# Autodesk Inventor assembly: Assembly1
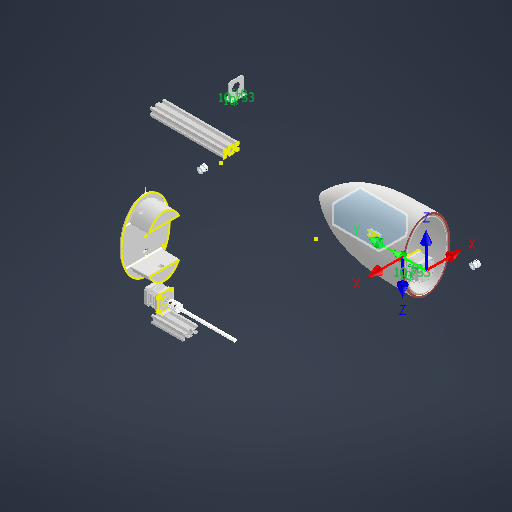
[picture p0: Inventor's stored thumbnail of the model, 512x512]
Saved by Autodesk Inventor 2027 (Build 310192060, 192F)
## iProperties
Created: 2026-06-12
Part Number: Assembly1
Document SubType Name: Assembly
Designer: thita
Author: thita
## Documents named in this file (26)
- D:\Year2\đồ án tốt nghịp\new fish\DESIGN_VIT_ME\Workgroups\new\Assembly1.iam
- D:\Year2\đồ án tốt nghịp\new fish\DESIGN_VIT_ME\Workgroups\new\DESIGN\Workgroups\NotInProject\NotInProject\DAU.ipt
- D:\Year2\đồ án tốt nghịp\new fish\DESIGN_VIT_ME\Workgroups\new\GP2Y0A02YK0F SHARP.ipt
- D:\Year2\đồ án tốt nghịp\new fish\DESIGN_VIT_ME\Workgroups\new\Khối pin sạc Li-ion 12V 21Ah 30A 3S MTM.ipt
- D:\Year2\đồ án tốt nghịp\new fish\DESIGN_VIT_ME\Workgroups\new\DESIGN\Workgroups\NotInProject\NotInProject\NAP.ipt
- D:\Year2\đồ án tốt nghịp\new fish\DESIGN_VIT_ME\Workgroups\new\2040ALUMINIUM PROFIL 35CM.ipt
- D:\Year2\đồ án tốt nghịp\new fish\DESIGN_VIT_ME\Workgroups\new\Step - Nema 17 - 17HS4401S - Usongshine.ipt
- D:\Year2\đồ án tốt nghịp\new fish\DESIGN_VIT_ME\Workgroups\new\GT2_20T.ipt
- D:\Year2\đồ án tốt nghịp\new fish\DESIGN_VIT_ME\Workgroups\new\gia_gan_stepper_va_2040.ipt
- D:\Year2\đồ án tốt nghịp\new fish\DESIGN_VIT_ME\Workgroups\new\2040ALUMINIUM PROFIL 35CM_MIR.ipt
- D:\Year2\đồ án tốt nghịp\new fish\DESIGN_VIT_ME\Workgroups\new\Step - Nema 17 - 17HS4401S - Usongshine_MIR.ipt
- D:\Year2\đồ án tốt nghịp\new fish\DESIGN_VIT_ME\Workgroups\new\gia_gan_stepper_va_2040_MIR.ipt
- D:\Year2\đồ án tốt nghịp\new fish\DESIGN_VIT_ME\Workgroups\new\GT2_20T_MIR2.ipt
- D:\Year2\đồ án tốt nghịp\new fish\DESIGN_VIT_ME\Workgroups\new\Step - Nema 17 - 17HS4401S - Usongshine_MIR_MIR.ipt
- D:\Year2\đồ án tốt nghịp\new fish\DESIGN_VIT_ME\Workgroups\new\GT2_20T_MIR2_MIR.ipt
- D:\Year2\đồ án tốt nghịp\new fish\DESIGN_VIT_ME\Workgroups\new\Gia_truc_z.ipt
- D:\Year2\đồ án tốt nghịp\new fish\DESIGN_VIT_ME\Workgroups\new\5mm to 8mm rigid shaft coupler v2.ipt
- D:\Year2\đồ án tốt nghịp\new fish\DESIGN_VIT_ME\Workgroups\new\vitme-t8-buoc2.ipt
- D:\Year2\đồ án tốt nghịp\new fish\DESIGN_VIT_ME\Workgroups\new\2040ALUMINIUM PROFIL 35CM_MIR_MIR.ipt
- D:\Year2\đồ án tốt nghịp\new fish\DESIGN_VIT_ME\Workgroups\new\gia_gan_stepper_va_2040_MIR_MIR_MIR.ipt
- D:\Year2\đồ án tốt nghịp\new fish\DESIGN_VIT_ME\Workgroups\new\GT2_20T_MIR2_MIR_MIR.ipt
- D:\Year2\đồ án tốt nghịp\new fish\DESIGN_VIT_ME\Workgroups\new\Step - Nema 17 - 17HS4401S - Usongshine_MIR1.ipt
- D:\Year2\đồ án tốt nghịp\new fish\DESIGN_VIT_ME\Workgroups\new\Gia_truc_z_MIR.ipt
- D:\Year2\đồ án tốt nghịp\new fish\DESIGN_VIT_ME\Workgroups\new\5mm to 8mm rigid shaft coupler v2_MIR.ipt
- D:\Year2\đồ án tốt nghịp\new fish\DESIGN_VIT_ME\Workgroups\new\vitme-t8-buoc2_MIR.ipt
- D:\Year2\đồ án tốt nghịp\new fish\DESIGN_VIT_ME\Workgroups\new\Goi Do Dai Oc.ipt
## Components (28 placed, 25 different names)
1. DAU:1 — Mate:4, Mate:5, Mate:6, Mate:7
2. GP2Y0A02YK0F SHARP:1 — Mate:6, Mate:7
3. GP2Y0A02YK0F SHARP:2 — Mate:4, Mate:5
4. Khối pin sạc Li-ion 12V 21Ah 30A 3S MTM:1 — Mate:22
5. NAP:1
6. 2040ALUMINIUM PROFIL 35CM:1 — Mate:1, Mate:2, Mate:3
7. Step - Nema 17 - 17HS4401S - Usongshine:1 — Rigid:1, Rigid:2
8. GT2_20T:1 — Rigid:2
9. gia_gan_stepper_va_2040:1 — Rigid:1, Mate:1, Mate:2, Mate:3
10. 2040ALUMINIUM PROFIL 35CM_MIR:1 — Mate:8, Mate:10, Mate:15, Mate:21, Mate:23
11. Step - Nema 17 - 17HS4401S - Usongshine_MIR:1 — Rigid:4
12. gia_gan_stepper_va_2040_MIR:1 — Mate:8, Mate:10, Rigid:4
13. GT2_20T_MIR2:1
14. Step - Nema 17 - 17HS4401S - Usongshine_MIR_MIR:1 — Rotational:1
15. GT2_20T_MIR2_MIR:1 — Rotational:1
16. Step - Nema 17 - 17HS4401S - Usongshine:2 — Rigid:6, Rotational:2
17. Goi Do Dai Oc:1 — Mate:21, Mate:22
18. Gia_truc_z:1 — Rigid:6, Mate:15, Mate:23
19. 5mm to 8mm rigid shaft coupler v2:1 — Rotational:2, Rigid:7
20. vitme-t8-buoc2:1 — Rigid:7
21. Gia_truc_z:2
22. 2040ALUMINIUM PROFIL 35CM_MIR_MIR:1 — Mate:16, Mate:17, Mate:18, Mate:19, Mate:20
23. gia_gan_stepper_va_2040_MIR_MIR_MIR:1 — Mate:16, Mate:17, Mate:18
24. GT2_20T_MIR2_MIR_MIR:1
25. Step - Nema 17 - 17HS4401S - Usongshine_MIR1:1 — Rigid:8, Rotational:3
26. Gia_truc_z_MIR:1 — Mate:19, Mate:20, Rigid:8
27. 5mm to 8mm rigid shaft coupler v2_MIR:1 — Rotational:3, Rigid:9
28. vitme-t8-buoc2_MIR:1 — Rigid:9
## Relationships (28: Mate 18, WeldJoint 7, RevoluteJoint 3)
- Rigid:1 [WeldJoint]: Step - Nema 17 - 17HS4401S - Usongshine:1 ↔ gia_gan_stepper_va_2040:1
- Mate:1: 2040ALUMINIUM PROFIL 35CM:1 ↔ gia_gan_stepper_va_2040:1
- Mate:2: 2040ALUMINIUM PROFIL 35CM:1 ↔ gia_gan_stepper_va_2040:1
- Mate:3 (20 mm): 2040ALUMINIUM PROFIL 35CM:1 ↔ gia_gan_stepper_va_2040:1
- Rigid:2 [WeldJoint] (-13 mm): Step - Nema 17 - 17HS4401S - Usongshine:1 ↔ GT2_20T:1
- Mate:4: DAU:1 ↔ GP2Y0A02YK0F SHARP:2
- Mate:5: DAU:1 ↔ GP2Y0A02YK0F SHARP:2
- Mate:6: DAU:1 ↔ GP2Y0A02YK0F SHARP:1
- Mate:7: DAU:1 ↔ GP2Y0A02YK0F SHARP:1
- Mate:8 (20 mm): 2040ALUMINIUM PROFIL 35CM_MIR:1 ↔ gia_gan_stepper_va_2040_MIR:1
- Mate:10: 2040ALUMINIUM PROFIL 35CM_MIR:1 ↔ gia_gan_stepper_va_2040_MIR:1
- Rigid:4 [WeldJoint]: Step - Nema 17 - 17HS4401S - Usongshine_MIR:1 ↔ gia_gan_stepper_va_2040_MIR:1
- Rotational:1 [RevoluteJoint] (3 mm): Step - Nema 17 - 17HS4401S - Usongshine_MIR_MIR:1 ↔ GT2_20T_MIR2_MIR:1
- Rigid:6 [WeldJoint]: Step - Nema 17 - 17HS4401S - Usongshine:2 ↔ Gia_truc_z:1
- Rotational:2 [RevoluteJoint] (-10 mm): Step - Nema 17 - 17HS4401S - Usongshine:2 ↔ 5mm to 8mm rigid shaft coupler v2:1
- Rigid:7 [WeldJoint] (-5 mm): 5mm to 8mm rigid shaft coupler v2:1 ↔ vitme-t8-buoc2:1
- Mate:15: 2040ALUMINIUM PROFIL 35CM_MIR:1 ↔ Gia_truc_z:1
- Mate:16 (25 mm): 2040ALUMINIUM PROFIL 35CM_MIR_MIR:1 ↔ gia_gan_stepper_va_2040_MIR_MIR_MIR:1
- Mate:17: 2040ALUMINIUM PROFIL 35CM_MIR_MIR:1 ↔ gia_gan_stepper_va_2040_MIR_MIR_MIR:1
- Mate:18: 2040ALUMINIUM PROFIL 35CM_MIR_MIR:1 ↔ gia_gan_stepper_va_2040_MIR_MIR_MIR:1
- Mate:19: 2040ALUMINIUM PROFIL 35CM_MIR_MIR:1 ↔ Gia_truc_z_MIR:1
- Mate:20: 2040ALUMINIUM PROFIL 35CM_MIR_MIR:1 ↔ Gia_truc_z_MIR:1
- Rigid:8 [WeldJoint]: Step - Nema 17 - 17HS4401S - Usongshine_MIR1:1 ↔ Gia_truc_z_MIR:1
- Rotational:3 [RevoluteJoint] (-10 mm): Step - Nema 17 - 17HS4401S - Usongshine_MIR1:1 ↔ 5mm to 8mm rigid shaft coupler v2_MIR:1
- Rigid:9 [WeldJoint] (5 mm): 5mm to 8mm rigid shaft coupler v2_MIR:1 ↔ vitme-t8-buoc2_MIR:1
- Mate:21 (10 mm): 2040ALUMINIUM PROFIL 35CM_MIR:1 ↔ Goi Do Dai Oc:1
- Mate:22 (3 mm): Khối pin sạc Li-ion 12V 21Ah 30A 3S MTM:1 ↔ Goi Do Dai Oc:1
- Mate:23: 2040ALUMINIUM PROFIL 35CM_MIR:1 ↔ Gia_truc_z:1
## Named parameters: Finish2_Area = 9.80067, Finish3_Area = 16.8006, Finish4_Area = 23.6105, Finish5_Area = 23.6105
note: some values were not read from the file. Shown as the stored number, unit unknown: "Finish2_Area", "Finish3_Area", "Finish4_Area", "Finish5_Area".
